# Autodesk Inventor assembly: ASM_grand_Robot_1
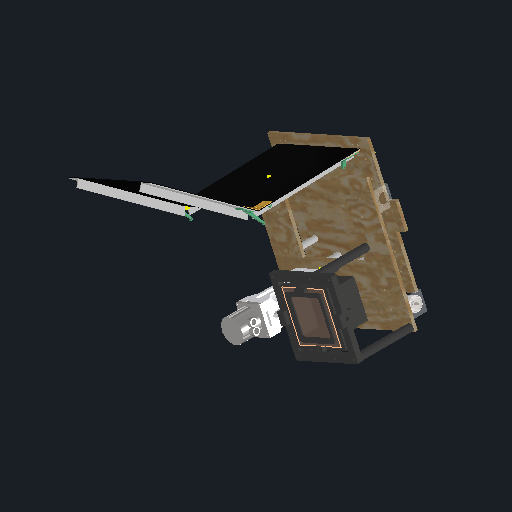
[picture p0: Inventor's stored thumbnail of the model, 512x512]
Saved by Autodesk Inventor 2026 (Build 300175050, 175E)
## iProperties
Created: 2025-05-12
Part Number: ASM_grand_Robot_1
Document SubType Name: Assembly
Designer: karle
Author: karle
## iProperties of the stored document Modelcraft RB350030-0A101R.ipt
Created: 1601-01-03
Part Number: Modelcraft RB350030-0A101R
Material: 1.0037 (S235JR)
Document SubType Name: Modeling
Designer: karle
Density: 7.8 g/cm^3
Appearance: carbon steel
Sending System: SOLIDWORKS 2019
Last Saved Date: 1601-01-01
last saved by: Kevin
Author: karle
## Documents named in this file (12)
- C:\Users\karle\OneDrive - HESSO\P2511_Dossier_partage_RVEZ\01_Robot\0101_CAO\ASM_grand_Robot_1.iam
- C:\Users\karle\OneDrive - HESSO\P2511_Dossier_partage_RVEZ\01_Robot\0101_CAO\0_Châssis\02_Grand Châssis\plateau_grand_robot.ipt
- C:\Users\karle\OneDrive - HESSO\P2511_Dossier_partage_RVEZ\01_Robot\0101_CAO\0_Châssis\02_Grand Châssis\plateau_grand_robot_bas.ipt
- C:\Users\karle\OneDrive - HESSO\P2511_Dossier_partage_RVEZ\01_Robot\0101_CAO\0_Châssis\02_Grand Châssis\plateau_grand_robot_distance.ipt
- C:\Users\karle\OneDrive - HESSO\P2511_Dossier_partage_RVEZ\01_Robot\0101_CAO\5_Pompe\5_1_pompe_model_1.1.ipt
- C:\Users\karle\OneDrive - HESSO\P2511_Dossier_partage_RVEZ\01_Robot\0101_CAO\5_Pompe\5_2_supports_moteur_pompe.ipt
- C:\Users\karle\OneDrive - HESSO\P2511_Dossier_partage_RVEZ\01_Robot\0101_CAO\Moteur\Support moteur.ipt
- **C:\Users\karle\OneDrive - HESSO\P2511_Dossier_partage_RVEZ\01_Robot\0101_CAO\ASM_grand_Robot_1.iam*LocalDocs*xAaaaahdaAaaaaaaaAaaaaupg5g*Modelcraft RB350030-0A101R.ipt
- C:\Users\karle\OneDrive - HESSO\P2511_Dossier_partage_RVEZ\01_Robot\0101_CAO\01_pont\1_pont.iam
- C:\Users\karle\OneDrive - HESSO\P2511_Dossier_partage_RVEZ\01_Robot\0101_CAO\2_Stabil\Stabilsateur1_1.iam
- **C:\Users\virgi\OneDrive - HESSO\Fichiers de Guerinet Rémi - P2511_Dossier_partage_RVEZ\01_Robot\0101_CAO\ASM_grand_Robot_1.iam*LocalDocs*xAaaaahdaAaaaaaaaAaaaaupg5g*Modelcraft RB350030-0A101R.ipt
- C:\Users\karle\OneDrive - HESSO\P2511_Dossier_partage_RVEZ\01_Robot\0101_CAO\Moteur\Modelcraft RB350030-0A101R.SLDPRT
## Components (18 placed, 9 different names)
1. plateau_grand_robot:1 — Einfügen:1, Einfügen:5, Einfügen:7, Einfügen:2, Einfügen:3, Einfügen:6, Einfügen:12, Einfügen:13, Einfügen:19, Einfügen:20, Einfügen:21, Passend:1, Einfügen:22, Einfügen:23, Einfügen:24, Einfügen:25, Passend:2, Einfügen:29, Tangential:1, Einfügen:31, Einfügen:32
2. plateau_grand_robot_bas:1 — Einfügen:8, Einfügen:9
3. plateau_grand_robot_distance:1 — Einfügen:1
4. plateau_grand_robot_distance:2 — Einfügen:3
5. plateau_grand_robot_distance:3 — Einfügen:2, Einfügen:8
6. plateau_grand_robot_distance:4 — Einfügen:5
7. plateau_grand_robot_distance:5 — Einfügen:6, Einfügen:9
8. plateau_grand_robot_distance:6 — Einfügen:7
9. 5_1_pompe_model_1.1:1 — Einfügen:14, Einfügen:15
10. 5_2_supports_moteur_pompe:1 — Einfügen:12, Einfügen:13, Einfügen:14, Einfügen:15
11. Support moteur:1 — Einfügen:21, Passend:1, Einfügen:26, Einfügen:27
12. Support moteur:2 — Einfügen:24, Einfügen:25
13. Support moteur:3 — Einfügen:22, Einfügen:23, Einfügen:28, Einfügen:30
14. Support moteur:4 — Einfügen:19, Einfügen:20
15. Modelcraft RB350030-0A101R:1 — Einfügen:28, Einfügen:30
16. Modelcraft RB350030-0A101R:2 — Einfügen:26, Einfügen:27
17. 1_pont:1 [sub-assembly] — Passend:2, Einfügen:29, Tangential:1
18. Stabilsateur1_1:1 [sub-assembly] — Einfügen:31, Einfügen:32
## Relationships (29: Insert 26, Mate 2, Tangent 1)
- Einfügen:1 [Insert]: plateau_grand_robot:1 ↔ plateau_grand_robot_distance:1
- Einfügen:5 [Insert]: plateau_grand_robot:1 ↔ plateau_grand_robot_distance:4
- Einfügen:7 [Insert]: plateau_grand_robot:1 ↔ plateau_grand_robot_distance:6
- Einfügen:2 [Insert]: plateau_grand_robot:1 ↔ plateau_grand_robot_distance:3
- Einfügen:3 [Insert]: plateau_grand_robot:1 ↔ plateau_grand_robot_distance:2
- Einfügen:6 [Insert]: plateau_grand_robot:1 ↔ plateau_grand_robot_distance:5
- Einfügen:8 [Insert]: plateau_grand_robot_bas:1 ↔ plateau_grand_robot_distance:3
- Einfügen:9 [Insert]: plateau_grand_robot_bas:1 ↔ plateau_grand_robot_distance:5
- Einfügen:12 [Insert]: plateau_grand_robot:1 ↔ 5_2_supports_moteur_pompe:1
- Einfügen:13 [Insert]: plateau_grand_robot:1 ↔ 5_2_supports_moteur_pompe:1
- Einfügen:14 [Insert]: 5_1_pompe_model_1.1:1 ↔ 5_2_supports_moteur_pompe:1
- Einfügen:15 [Insert]: 5_1_pompe_model_1.1:1 ↔ 5_2_supports_moteur_pompe:1
- Einfügen:19 [Insert]: plateau_grand_robot:1 ↔ Support moteur:4
- Einfügen:20 [Insert]: plateau_grand_robot:1 ↔ Support moteur:4
- Einfügen:21 [Insert]: plateau_grand_robot:1 ↔ Support moteur:1
- Passend:1 [Mate]: plateau_grand_robot:1 ↔ Support moteur:1
- Einfügen:22 [Insert]: plateau_grand_robot:1 ↔ Support moteur:3
- Einfügen:23 [Insert]: plateau_grand_robot:1 ↔ Support moteur:3
- Einfügen:24 [Insert]: plateau_grand_robot:1 ↔ Support moteur:2
- Einfügen:25 [Insert]: plateau_grand_robot:1 ↔ Support moteur:2
- Einfügen:26 [Insert]: Support moteur:1 ↔ Modelcraft RB350030-0A101R:2
- Einfügen:27 [Insert]: Support moteur:1 ↔ Modelcraft RB350030-0A101R:2
- Einfügen:28 [Insert]: Support moteur:3 ↔ Modelcraft RB350030-0A101R:1
- Passend:2 [Mate]: plateau_grand_robot:1 ↔ 1_pont:1
- Einfügen:29 [Insert]: plateau_grand_robot:1 ↔ 1_pont:1
- Tangential:1: plateau_grand_robot:1 ↔ 1_pont:1
- Einfügen:30 [Insert]: Support moteur:3 ↔ Modelcraft RB350030-0A101R:1
- Einfügen:31 [Insert]: plateau_grand_robot:1 ↔ Stabilsateur1_1:1
- Einfügen:32 [Insert]: plateau_grand_robot:1 ↔ Stabilsateur1_1:1
